# Autodesk Inventor assembly: 5521DC Power Box
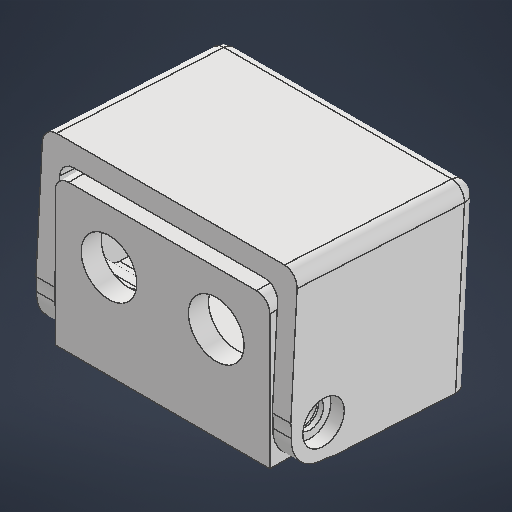
[picture p0: Inventor's stored thumbnail of the model, 512x512]
Saved by Autodesk Inventor 2026.2 (Build 302298010, 298A)
## iProperties
Created: 2026-05-09
Part Number: 5521DC Power Box
Document SubType Name: Assembly
Designer: work
Author: work
## Documents named in this file (3)
- C:\Users\work\Desktop\ARD_v1\ARD_hardware\PneumaticGripper_v1\5521DC Power Box.iam
- C:\Users\work\Desktop\ARD_v1\ARD_hardware\PneumaticGripper_v1\5521DC Power Box_b.ipt
- C:\Users\work\Desktop\ARD_v1\ARD_hardware\PneumaticGripper_v1\5521DC Power Box_A.ipt
## Components (2 placed, 2 different names)
1. 5521DC Power Box_b:1 — 플러쉬:1, 각도:1, 메이트:1, 메이트:2
2. 5521DC Power Box_A:1 — 플러쉬:1, 각도:1, 메이트:1, 메이트:2
## Relationships (4: Mate 2, Flush 1, Angle 1)
- 플러쉬:1 [Flush]: 5521DC Power Box_b:1 ↔ 5521DC Power Box_A:1
- 각도:1 [Angle] (0 deg): 5521DC Power Box_b:1 ↔ 5521DC Power Box_A:1
- 메이트:1 [Mate]: 5521DC Power Box_b:1 ↔ 5521DC Power Box_A:1
- 메이트:2 [Mate] (0.25 mm): 5521DC Power Box_b:1 ↔ 5521DC Power Box_A:1
